# Autodesk Inventor assembly: CY300210M8
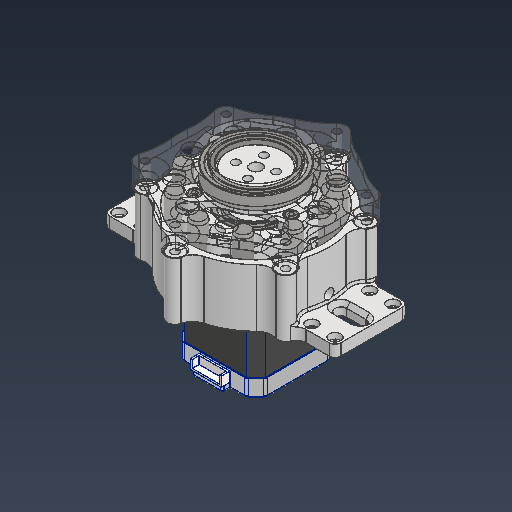
[picture p0: Inventor's stored thumbnail of the model, 512x512]
Saved by Autodesk Inventor 2026.2 (Build 302298010, 298A)
## iProperties
Created: 2026-04-07
Part Number: CY300210M8
Document SubType Name: Assembly
Designer: work
Author: work
## Documents named in this file (13)
- C:\Users\khw\Desktop\ARD_v1\ARD_hardware\CY300210M8_v1\CY300210M8.iam
- C:\Users\khw\Desktop\ARD_v1\ARD_hardware\CY300210M8_v1\disk.ipt
- C:\Users\khw\Desktop\ARD_v1\ARD_hardware\CY300210M8_v1\hou.ipt
- C:\Users\khw\Desktop\ARD_v1\ARD_hardware\CY300210M8_v1\roter.ipt
- C:\Users\khw\Desktop\ARD_v1\ARD_hardware\CY300210M8_v1\s1_v2.ipt
- C:\Users\khw\Desktop\ARD_v1\ARD_hardware\CY300210M8_v1\s2_v2.ipt
- C:\Users\khw\Desktop\ARD_v1\ARD_hardware\CY300210M8_v1\casing.ipt
- C:\Users\khw\Desktop\ARD_v1\ARD_hardware\ARD_Model_v1\NEMA17.ipt
- C:\Users\khw\Desktop\ARD_v1\ARD_hardware\CY300210M8_v1\KS B 2023 - 693 - 3 x 8 x 3 - 0.293.ipt
- C:\Users\khw\Desktop\ARD_v1\ARD_hardware\CY300210M8_v1\JIS B 1521 - 6804 20x32x7x4.ipt
- C:\Users\khw\Desktop\ARD_v1\ARD_hardware\CY300210M8_v1\JIS B 1521 - 6806 30x42x7x4.7.ipt
- C:\Users\khw\Desktop\ARD_v1\ARD_hardware\CY300210M8_v1\KS B 1003 - M 3 x 16.ipt
- C:\Users\khw\Desktop\ARD_v1\ARD_hardware\CY300210M8_v1\JIS B 1354 - B - 8 x 40.ipt
## Components (36 placed, 12 different names)
1. disk:1 — 메이트:13, 플러쉬:3, 회전:7, 회전:8, 회전:9
2. hou:1 — 메이트:1, 각도:1, 메이트:2, 회전:1, 회전:2, 회전:3, 회전:4, 메이트:12, 플러쉬:2, 메이트:24, 메이트:25, 메이트:26
3. roter:1 — 회전:13, 강체:1, 회전:14, 메이트:20, 메이트:23
4. s1_v2:1 — 메이트:7, 메이트:9, 회전:5, 회전:6, 메이트:11, 각도:2, 회전:1
5. s2_v2:1 — 메이트:3, 메이트:5, 메이트:6, 메이트:7, 메이트:9, 메이트:10, 플러쉬:1, 메이트:16
6. casing:1 — 메이트:21, 메이트:22, 메이트:24, 메이트:25, 메이트:26
7. disk:2 — 회전:11, 메이트:14, 메이트:15, 메이트:16, 메이트:17, 회전:1
8. NEMA17:1 — 메이트:1, 각도:1, 메이트:2, 메이트:11, 플러쉬:1, 각도:2
9. KS B 2023 - 693 - 3 x 8 x 3 - 0.293:1 — 회전:9
10. KS B 2023 - 693 - 3 x 8 x 3 - 0.293:2 — 회전:8
11. KS B 2023 - 693 - 3 x 8 x 3 - 0.293:3 — 회전:7
12. JIS B 1521 - 6804 20x32x7x4:1 — 메이트:3, 메이트:14, 메이트:15
13. JIS B 1521 - 6806 30x42x7x4.7:1 — 메이트:20, 메이트:21, 메이트:22, 메이트:23
14. KS B 1003 - M 3 x 16:1 — 회전:1
15. KS B 1003 - M 3 x 16:2 — 회전:2
16. KS B 1003 - M 3 x 16:3 — 회전:3
17. KS B 1003 - M 3 x 16:4 — 회전:13, 메이트:17
18. KS B 1003 - M 3 x 16:5 — 회전:5
19. KS B 1003 - M 3 x 16:6 — 회전:4
20. JIS B 1521 - 6804 20x32x7x4:2 — 메이트:5, 메이트:6, 메이트:13, 플러쉬:3
21. KS B 1003 - M 3 x 16:7 — 강체:1, 메이트:18
22. KS B 1003 - M 3 x 16:8 — 회전:6, 메이트:10
23. KS B 2023 - 693 - 3 x 8 x 3 - 0.293:4 — 메이트:19
24. KS B 2023 - 693 - 3 x 8 x 3 - 0.293:5 — 회전:11
25. KS B 2023 - 693 - 3 x 8 x 3 - 0.293:6 — 메이트:18
26. KS B 1003 - M 3 x 16:9 — 회전:14, 메이트:19
27. JIS B 1354 - B - 8 x 40:1 — 메이트:12, 플러쉬:2
28. JIS B 1354 - B - 8 x 40:2
29. JIS B 1354 - B - 8 x 40:3
30. JIS B 1354 - B - 8 x 40:4
31. JIS B 1354 - B - 8 x 40:5
32. JIS B 1354 - B - 8 x 40:6
33. JIS B 1354 - B - 8 x 40:7
34. JIS B 1354 - B - 8 x 40:8
35. JIS B 1354 - B - 8 x 40:9
36. JIS B 1354 - B - 8 x 40:10
## Component patterns: (10 elements, first: JIS B 1354 - B - 8 x 40:1)
## Relationships (45: Mate 24, RevoluteJoint 14, Flush 3, Angle 2, WeldJoint 1, RelateRotation 1)
- 메이트:1 [Mate]: hou:1 ↔ NEMA17:1
- 각도:1 [Angle] (0 deg): hou:1 ↔ NEMA17:1
- 메이트:2 [Mate]: hou:1 ↔ NEMA17:1
- 회전:1 [RevoluteJoint]: hou:1 ↔ KS B 1003 - M 3 x 16:1
- 회전:2 [RevoluteJoint]: hou:1 ↔ KS B 1003 - M 3 x 16:2
- 회전:3 [RevoluteJoint]: hou:1 ↔ KS B 1003 - M 3 x 16:3
- 회전:4 [RevoluteJoint]: hou:1 ↔ KS B 1003 - M 3 x 16:6
- 메이트:3 [Mate]: s2_v2:1 ↔ JIS B 1521 - 6804 20x32x7x4:1
- 메이트:5 [Mate]: s2_v2:1 ↔ JIS B 1521 - 6804 20x32x7x4:2
- 메이트:6 [Mate]: s2_v2:1 ↔ JIS B 1521 - 6804 20x32x7x4:2
- 메이트:7 [Mate]: s1_v2:1 ↔ s2_v2:1
- 메이트:9 [Mate]: s1_v2:1 ↔ s2_v2:1
- 회전:5 [RevoluteJoint]: s1_v2:1 ↔ KS B 1003 - M 3 x 16:5
- 회전:6 [RevoluteJoint]: s1_v2:1 ↔ KS B 1003 - M 3 x 16:8
- 메이트:10 [Mate]: s2_v2:1 ↔ KS B 1003 - M 3 x 16:8
- 메이트:11 [Mate]: s1_v2:1 ↔ NEMA17:1
- 플러쉬:1 [Flush] (8 mm): s2_v2:1 ↔ NEMA17:1
- 메이트:12 [Mate]: hou:1 ↔ JIS B 1354 - B - 8 x 40:1
- 플러쉬:2 [Flush]: hou:1 ↔ JIS B 1354 - B - 8 x 40:1
- 메이트:13 [Mate]: disk:1 ↔ JIS B 1521 - 6804 20x32x7x4:2
- 플러쉬:3 [Flush]: disk:1 ↔ JIS B 1521 - 6804 20x32x7x4:2
- 회전:7 [RevoluteJoint]: disk:1 ↔ KS B 2023 - 693 - 3 x 8 x 3 - 0.293:3
- 회전:8 [RevoluteJoint]: disk:1 ↔ KS B 2023 - 693 - 3 x 8 x 3 - 0.293:2
- 회전:9 [RevoluteJoint]: disk:1 ↔ KS B 2023 - 693 - 3 x 8 x 3 - 0.293:1
- [RevoluteJoint]: disk:2 ↔ KS B 2023 - 693 - 3 x 8 x 3 - 0.293:6
- 회전:11 [RevoluteJoint]: disk:2 ↔ KS B 2023 - 693 - 3 x 8 x 3 - 0.293:5
- [RevoluteJoint]: disk:2 ↔ KS B 2023 - 693 - 3 x 8 x 3 - 0.293:4
- 메이트:14 [Mate]: disk:2 ↔ JIS B 1521 - 6804 20x32x7x4:1
- 메이트:15 [Mate]: disk:2 ↔ JIS B 1521 - 6804 20x32x7x4:1
- 메이트:16 [Mate]: s2_v2:1 ↔ disk:2
- 회전:13 [RevoluteJoint]: roter:1 ↔ KS B 1003 - M 3 x 16:4
- 강체:1 [WeldJoint]: roter:1 ↔ KS B 1003 - M 3 x 16:7
- 회전:14 [RevoluteJoint]: roter:1 ↔ KS B 1003 - M 3 x 16:9
- 메이트:17 [Mate]: disk:2 ↔ KS B 1003 - M 3 x 16:4
- 메이트:18 [Mate]: KS B 1003 - M 3 x 16:7 ↔ KS B 2023 - 693 - 3 x 8 x 3 - 0.293:6
- 메이트:19 [Mate]: KS B 2023 - 693 - 3 x 8 x 3 - 0.293:4 ↔ KS B 1003 - M 3 x 16:9
- 메이트:20 [Mate]: roter:1 ↔ JIS B 1521 - 6806 30x42x7x4.7:1
- 메이트:21 [Mate]: casing:1 ↔ JIS B 1521 - 6806 30x42x7x4.7:1
- 메이트:22 [Mate]: casing:1 ↔ JIS B 1521 - 6806 30x42x7x4.7:1
- 메이트:23 [Mate] (3 mm): roter:1 ↔ JIS B 1521 - 6806 30x42x7x4.7:1
- 메이트:24 [Mate]: hou:1 ↔ casing:1
- 메이트:25 [Mate]: hou:1 ↔ casing:1
- 메이트:26 [Mate]: hou:1 ↔ casing:1
- 각도:2 [Angle] (0 deg): s1_v2:1 ↔ NEMA17:1
- 회전:1 [RelateRotation] (0.1111 ul): s1_v2:1 ↔ disk:2
## Named parameters: d39_d33 = 0 mm, d40_d34 = 97.004107 deg, d41_d35 = 0 mm, d42_d36 = -14.712168 deg, d43_d37 = 0 mm, d44_d38 = -99.795388 deg
